# Autodesk Inventor assembly: pl_v2
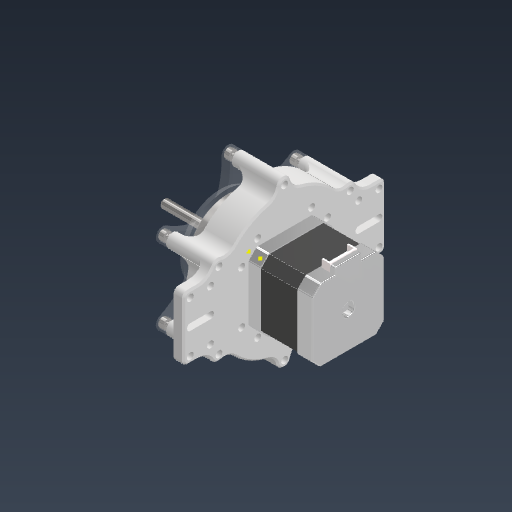
[picture p0: Inventor's stored thumbnail of the model, 512x512]
Saved by Autodesk Inventor 2026.2 (Build 302298010, 298A)
## iProperties
Created: 2026-05-29
Part Number: pl_v2
Document SubType Name: Assembly
Designer: khw
Author: khw
## Documents named in this file (3)
- C:\Users\khw\Desktop\ARD_v1\ARD_hardware\PL121248m2Drive_v2\pl_v2.iam
- C:\Users\khw\Desktop\ARD_v1\ARD_hardware\PL121248m2Drive_v2\pl_v1.iam
- C:\Users\khw\Desktop\ARD_v1\ARD_hardware\PL121248m2Drive_v2\KS B 1003 - M 3 x 12.ipt
## Components (6 placed, 2 different names)
1. pl_v1:1 [sub-assembly] — 삽입:1, 삽입:2, 삽입:3, 삽입:4, 삽입:5
2. KS B 1003 - M 3 x 12:1 — 삽입:1
3. KS B 1003 - M 3 x 12:2 — 삽입:2
4. KS B 1003 - M 3 x 12:3 — 삽입:3
5. KS B 1003 - M 3 x 12:4 — 삽입:4
6. KS B 1003 - M 3 x 12:5 — 삽입:5
## Relationships (5: Insert 5)
- 삽입:1 [Insert]: pl_v1:1 ↔ KS B 1003 - M 3 x 12:1
- 삽입:2 [Insert]: pl_v1:1 ↔ KS B 1003 - M 3 x 12:2
- 삽입:3 [Insert]: pl_v1:1 ↔ KS B 1003 - M 3 x 12:3
- 삽입:4 [Insert]: pl_v1:1 ↔ KS B 1003 - M 3 x 12:4
- 삽입:5 [Insert]: pl_v1:1 ↔ KS B 1003 - M 3 x 12:5
